# Autodesk Inventor assembly: Ensemble1
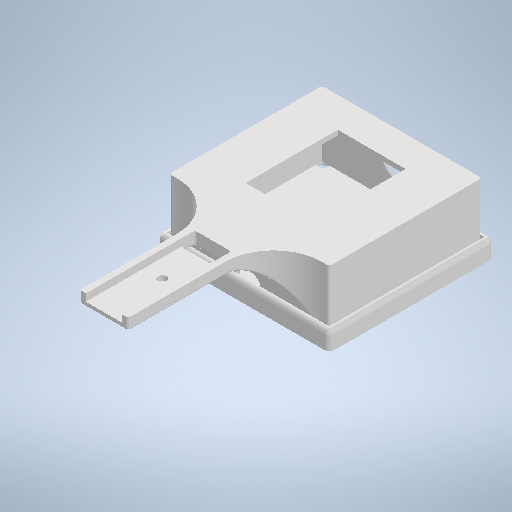
[picture p0: Inventor's stored thumbnail of the model, 512x512]
Saved by Autodesk Inventor 2025.2 (Build 292293000, 293)
## iProperties
Created: 2026-08-28
Part Number: Ensemble1
Document SubType Name: Assembly
Designer: mattéo
Author: mattéo
## Documents named in this file (3)
- C:\Users\mattéo\Documents\projet\compteur_bouteille\Ensemble1.iam
- C:\Users\mattéo\Documents\projet\compteur_bouteille\socle.ipt
- C:\Users\mattéo\Documents\projet\compteur_bouteille\top.ipt
## Components (2 placed, 2 different names)
1. socle:1 — Affleurement:1
2. top:1 — Affleurement:1
## Relationships (1: Flush 1)
- Affleurement:1 [Flush]: socle:1 ↔ top:1
